# Autodesk Inventor assembly: Assembly1
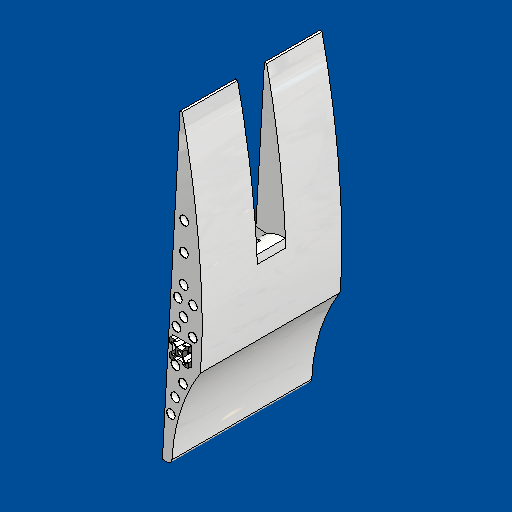
[picture p0: Inventor's stored thumbnail of the model, 512x512]
Saved by Autodesk Inventor 2027.1 (Build 311270010, 270A)
## iProperties
Created: 2026-10-14
Part Number: Assembly1
Document SubType Name: Assembly
Designer: mateo
Author: mateo
## Documents named in this file (5)
- C:\GitHub\SWIFT-UAV\System_development\Pelican\structural_model\v0.3.1\MainAssembly\Assembly1.iam
- C:\GitHub\SWIFT-UAV\System_development\Pelican\structural_model\v0.3.1\Parts\Fuselage\FuselageV3.ipt
- C:\GitHub\SWIFT-UAV\System_development\Pelican\structural_model\v0.3.1\Parts\Wings\WingBox_v2.ipt
- C:\GitHub\SWIFT-UAV\System_development\Pelican\structural_model\v0.3.1\Parts\Ancillary Components\2020 T Plate Bracket Connectors .ipt
- C:\GitHub\SWIFT-UAV\System_development\Pelican\structural_model\v0.3.1\Parts\Aluminum_20x20\20x20x130ExtrudedAluminum.ipt
## Components (4 placed, 4 different names)
1. FuselageV3:1 — Mate:1, Mate:2
2. WingBox_v2:1 — Mate:1, Mate:2, Mate:3, Mate:4, Mate:6
3. 2020 T Plate Bracket Connectors :1 — Mate:5, Mate:6
4. 20x20x130ExtrudedAluminum:1 — Mate:3, Mate:4, Mate:5
## Relationships (6: Mate 6)
- Mate:1: FuselageV3:1 ↔ WingBox_v2:1
- Mate:2: FuselageV3:1 ↔ WingBox_v2:1
- Mate:3: WingBox_v2:1 ↔ 20x20x130ExtrudedAluminum:1
- Mate:4: WingBox_v2:1 ↔ 20x20x130ExtrudedAluminum:1
- Mate:5: 2020 T Plate Bracket Connectors :1 ↔ 20x20x130ExtrudedAluminum:1
- Mate:6: WingBox_v2:1 ↔ 2020 T Plate Bracket Connectors :1
